# Autodesk Inventor assembly: B_Foot_v2
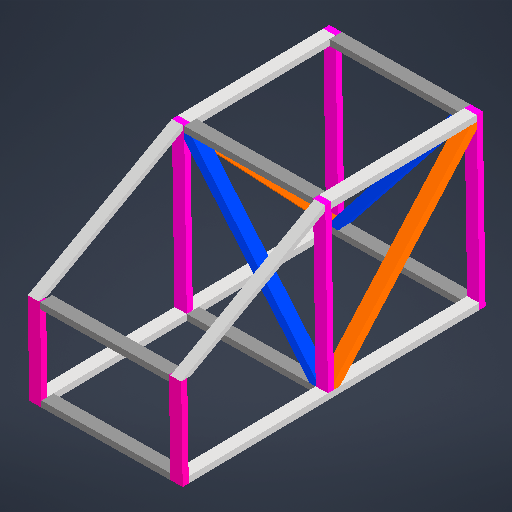
[picture p0: Inventor's stored thumbnail of the model, 512x512]
Saved by Autodesk Inventor 2027 (Build 310192000, 192)
## iProperties
Created: 2026-08-30
Part Number: B_Foot_v2
Document SubType Name: Assembly
Designer: jorda
Author: jorda
## Documents named in this file (10)
- C:\Users\lucas\Downloads\B_Foot_v2 - Copy (1).iam
- C:\Users\lucas\OneDrive\Documents\Inventor\Tiger Burn Head Frame 2026\2x4x96.ipt
- C:\Users\lucas\Downloads\2x4x42.ipt
- C:\Users\lucas\OneDrive\Documents\Inventor\Tiger Burn Head Frame 2026\2x4x30.ipt
- C:\Users\lucas\Downloads\S_2x4x54.35.ipt
- C:\Users\lucas\Downloads\S_2x4x65.8.ipt
- C:\Users\lucas\OneDrive\Documents\Inventor\Tiger Burn Head Frame 2026\2x4x72.ipt
- C:\Users\lucas\OneDrive\Documents\Inventor\Tiger Burn Head Frame 2026\2x4x53.5.ipt
- C:\Users\lucas\OneDrive\Documents\Inventor\Tiger Burn Head Frame 2026\2x4xVV.ipt
- C:\Users\lucas\OneDrive\Documents\Inventor\Tiger Burn Head Frame 2026\2x4x74.ipt
## Components (22 placed, 10 different names)
1. 2x4x42:1 — Mate:6, Flush:11, Flush:17, Flush:19, Flush:20, Flush:46, Flush:47
2. 2x4x42:2 — Flush:4, Flush:5, Mate:3, Flush:6, Mate:4, Flush:7
3. 2x4x96:3 — Mate:1, Flush:1, Flush:2, Flush:21, Mate:10, Flush:22, Flush:23, Flush:24, Flush:25
4. 2x4x42:3 — Mate:19, Flush:42, Flush:43
5. 2x4x42:4 — Mate:16, Flush:31, Flush:32, Flush:49, Mate:23
6. 2x4x42:5 — Flush:29, Mate:15, Flush:30
7. 2x4x30:1 — Mate:1, Flush:1, Flush:2, Flush:3, Mate:2, Flush:4, Flush:5, Mate:3, Flush:26
8. S_2x4x54.35:1 — Flush:3, Mate:2, Mate:11
9. S_2x4x54.35:2 — Flush:28, Mate:13, Mate:14
10. 2x4x42:6 — Mate:17, Flush:34, Flush:35
11. 2x4x68 — Flush:44
12. S_2x4x65.8:2 — Flush:45, Mate:20, Mate:21
13. 2x4x96:2 — Mate:5, Flush:8, Flush:9, Mate:6, Flush:11, Flush:14, Flush:15, Flush:16, Mate:9, Flush:18, Flush:27, Mate:12, Mate:15, Flush:30, Mate:20
14. 2x4x30:2 — Flush:6, Mate:4, Flush:7, Mate:5, Flush:8, Flush:9, Mate:13, Mate:17, Flush:34, Flush:35
15. 2x4x55.5 — Flush:14, Flush:15, Flush:16, Flush:17, Mate:9, Flush:18, Flush:19, Flush:20, Mate:19, Flush:42, Mate:21, Flush:48
16. 2x4x55.5:2 — Flush:21, Mate:10, Flush:22
17. 2x4x53.5:1 — Flush:23, Flush:24, Flush:25, Mate:11, Flush:26, Flush:29, Mate:16, Flush:31, Flush:32, Flush:33, Flush:36, Flush:37, Flush:38, Flush:39, Flush:44
18. 2x4x53.5:2 — Flush:27, Mate:12, Flush:28, Mate:14, Flush:33, Flush:40, Flush:41, Mate:18, Flush:45, Mate:22
19. 2x4x48:1 — Flush:36, Flush:37, Flush:38, Flush:39
20. 2x4x48 — Flush:40, Flush:41, Mate:18, Flush:43
21. 2x4x63:1 — Flush:46, Flush:47, Flush:48
22. 2x4x63:2 — Mate:22, Flush:49, Mate:23
## Relationships (67: Flush 46, Mate 21)
- Mate:1: 2x4x96:3 ↔ 2x4x30:1
- Flush:1: 2x4x96:3 ↔ 2x4x30:1
- Flush:2: 2x4x96:3 ↔ 2x4x30:1
- Flush:3: 2x4x30:1 ↔ S_2x4x54.35:1
- Mate:2: 2x4x30:1 ↔ S_2x4x54.35:1
- Flush:4: 2x4x42:2 ↔ 2x4x30:1
- Flush:5: 2x4x42:2 ↔ 2x4x30:1
- Mate:3: 2x4x42:2 ↔ 2x4x30:1
- Flush:6: 2x4x42:2 ↔ 2x4x30:2
- Mate:4: 2x4x42:2 ↔ 2x4x30:2
- Flush:7: 2x4x42:2 ↔ 2x4x30:2
- Mate:5: 2x4x96:2 ↔ 2x4x30:2
- Flush:8: 2x4x96:2 ↔ 2x4x30:2
- Flush:9: 2x4x96:2 ↔ 2x4x30:2
- Mate:6: 2x4x42:1 ↔ 2x4x96:2
- Flush:11: 2x4x42:1 ↔ 2x4x96:2
- Flush:14: 2x4x96:2 ↔ 2x4x55.5
- Flush:15: 2x4x96:2 ↔ 2x4x55.5
- Flush:16: 2x4x96:2 ↔ 2x4x55.5
- Flush:17: 2x4x42:1 ↔ 2x4x55.5
- Mate:9: 2x4x96:2 ↔ 2x4x55.5
- Flush:18: 2x4x96:2 ↔ 2x4x55.5
- Flush:19: 2x4x42:1 ↔ 2x4x55.5
- Flush:20: 2x4x42:1 ↔ 2x4x55.5
- Flush:21: 2x4x96:3 ↔ 2x4x55.5:2
- Mate:10: 2x4x96:3 ↔ 2x4x55.5:2
- Flush:22: 2x4x96:3 ↔ 2x4x55.5:2
- Flush:23: 2x4x96:3 ↔ 2x4x53.5:1
- Flush:24: 2x4x96:3 ↔ 2x4x53.5:1
- Flush:25: 2x4x96:3 ↔ 2x4x53.5:1
- Mate:11: S_2x4x54.35:1 ↔ 2x4x53.5:1
- Flush:26 (1219.2 mm): 2x4x30:1 ↔ 2x4x53.5:1
- Flush:27: 2x4x96:2 ↔ 2x4x53.5:2
- Mate:12: 2x4x96:2 ↔ 2x4x53.5:2
- Flush:28: S_2x4x54.35:2 ↔ 2x4x53.5:2
- Mate:13: S_2x4x54.35:2 ↔ 2x4x30:2
- Mate:14: S_2x4x54.35:2 ↔ 2x4x53.5:2
- Flush:29: 2x4x42:5 ↔ 2x4x53.5:1
- Mate:15: 2x4x42:5 ↔ 2x4x96:2
- Flush:30: 2x4x42:5 ↔ 2x4x96:2
- Mate:16: 2x4x42:4 ↔ 2x4x53.5:1
- Flush:31: 2x4x42:4 ↔ 2x4x53.5:1
- Flush:32: 2x4x42:4 ↔ 2x4x53.5:1
- Flush:33: 2x4x53.5:1 ↔ 2x4x53.5:2
- Mate:17: 2x4x42:6 ↔ 2x4x30:2
- Flush:34: 2x4x42:6 ↔ 2x4x30:2
- Flush:35: 2x4x42:6 ↔ 2x4x30:2
- Flush:36: 2x4x53.5:1 ↔ 2x4x48:1
- Flush:37: 2x4x53.5:1 ↔ 2x4x48:1
- Flush:38: 2x4x53.5:1 ↔ 2x4x48:1
- Flush:39: 2x4x53.5:1 ↔ 2x4x48:1
- Flush:40: 2x4x53.5:2 ↔ 2x4x48
- Flush:41: 2x4x53.5:2 ↔ 2x4x48
- Mate:18: 2x4x53.5:2 ↔ 2x4x48
- Mate:19: 2x4x42:3 ↔ 2x4x55.5
- Flush:42: 2x4x42:3 ↔ 2x4x55.5
- Flush:43: 2x4x42:3 ↔ 2x4x48
- Flush:44: 2x4x68 ↔ 2x4x53.5:1
- Flush:45: S_2x4x65.8:2 ↔ 2x4x53.5:2
- Mate:20: S_2x4x65.8:2 ↔ 2x4x96:2
- Mate:21: S_2x4x65.8:2 ↔ 2x4x55.5
- Flush:46: 2x4x42:1 ↔ 2x4x63:1
- Flush:47: 2x4x42:1 ↔ 2x4x63:1
- Flush:48: 2x4x55.5 ↔ 2x4x63:1
- Mate:22: 2x4x53.5:2 ↔ 2x4x63:2
- Flush:49: 2x4x42:4 ↔ 2x4x63:2
- Mate:23: 2x4x42:4 ↔ 2x4x63:2
